# Autodesk Inventor assembly: ROBOT_FISH_2
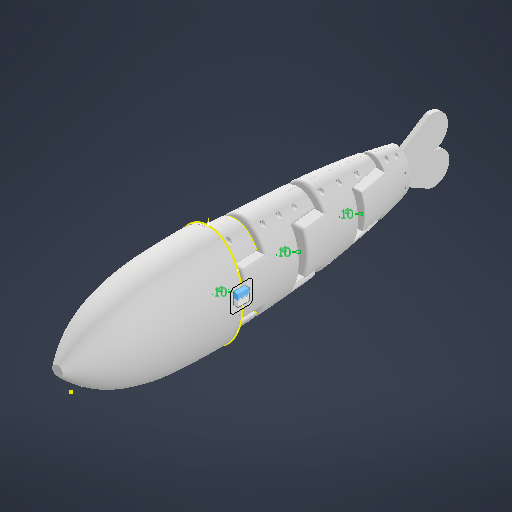
[picture p0: Inventor's stored thumbnail of the model, 512x512]
Saved by Autodesk Inventor 2026.2 (Build 302298000, 298)
## iProperties
Created: 2026-04-03
Part Number: ROBOT_FISH_2
Document SubType Name: Assembly
Designer: thita
Author: thita
## Documents named in this file (20)
- C:\Users\thita\ROBOT CÁ\ROBOT_FISH_2.iam
- C:\Users\thita\ROBOT CÁ\Solid10.ipt
- C:\Users\thita\ROBOT CÁ\Solid12.ipt
- C:\Users\thita\ROBOT CÁ\Solid14.ipt
- C:\Users\thita\ROBOT CÁ\Hop_co_servo.iam
- C:\Users\thita\ROBOT CÁ\truc_khop_1_MIR.ipt
- C:\Users\thita\ROBOT CÁ\truc_khop2_MIR.ipt
- C:\Users\thita\ROBOT CÁ\truc_khop_3_MIR.ipt
- C:\Users\thita\ROBOT CÁ\NotInProject\DAU.ipt
- C:\Users\thita\ROBOT CÁ\NotInProject\NAP.ipt
- C:\Users\thita\ROBOT CÁ\Solid14_MIR6.ipt
- C:\Users\thita\ROBOT CÁ\Solid12_MIR8.ipt
- C:\Users\thita\ROBOT CÁ\Solid10_MIR6.ipt
- C:\Users\thita\ROBOT CÁ\tail.ipt
- C:\Users\thita\ROBOT CÁ\SERVO DS35MG IP67.ipt
- C:\Users\thita\Downloads\Servo-9imod-DS35MG-180\Servo-9imod-DS35MG-180\Servo-9imod-DS35MG-180.ipt
- C:\Users\thita\ROBOT CÁ\Truc_khop_new_1.ipt
- C:\Users\thita\ROBOT CÁ\Truc_khop_new_2.ipt
- C:\Users\thita\ROBOT CÁ\Truc_khop_new_3.ipt
- C:\Users\thita\Downloads\CPB RACING BEARING (6001-2RSH) v3\CPB RACING BEARING (6001-2RSH) v3\CPB RACING BEARING (6001-2RSH) v3.ipt
## Components (26 placed, 19 different names)
1. Solid10:2 — Rigid:17, Rigid:24
2. Solid12:3 — Rigid:23, Rigid:30, Rigid:31, Rotational:9
3. Solid14:3 — Rigid:27, Rotational:7, Rigid:29, Rigid:32
4. Hop_co_servo:7 [sub-assembly] — Rigid:29
5. truc_khop_1_MIR:3
6. truc_khop2_MIR:3 — Rigid:32
7. truc_khop_3_MIR:3 — Rigid:31, Rotational:8
8. DAU:1 — Rigid:5
9. NAP:1 — Rigid:5, Rigid:20
10. Solid14_MIR6:1
11. Solid12_MIR8:1
12. Solid10_MIR6:1
13. tail:1 — Rigid:17
14. Hop_co_servo:10 [sub-assembly]
15. SERVO DS35MG IP67:1
16. Servo-9imod-DS35MG-180:1
17. Truc_khop_new_1:1 — Rigid:20
18. Truc_khop_new_2:1 — Rigid:30
19. Truc_khop_new_3:1 — Rigid:27
20. Hop_co_servo:11 [sub-assembly] — Rigid:23, Rigid:25
21. Hop_co_servo:12 [sub-assembly] — Rigid:24, Rigid:26
22. Servo-9imod-DS35MG-180:2 — Rigid:25
23. Servo-9imod-DS35MG-180:3 — Rigid:26
24. CPB RACING BEARING (6001-2RSH) v3:1 — Rotational:7
25. CPB RACING BEARING (6001-2RSH) v3:3 — Rotational:8
26. CPB RACING BEARING (6001-2RSH) v3:4 — Rotational:9
## Relationships (15: WeldJoint 12, RevoluteJoint 3)
- Rigid:5 [WeldJoint]: DAU:1 ↔ NAP:1
- Rigid:17 [WeldJoint]: Solid10:2 ↔ tail:1
- Rigid:20 [WeldJoint]: NAP:1 ↔ Truc_khop_new_1:1
- Rigid:23 [WeldJoint]: Solid12:3 ↔ Hop_co_servo:11
- Rigid:24 [WeldJoint]: Solid10:2 ↔ Hop_co_servo:12
- Rigid:25 [WeldJoint]: Hop_co_servo:11 ↔ Servo-9imod-DS35MG-180:2
- Rigid:26 [WeldJoint]: Hop_co_servo:12 ↔ Servo-9imod-DS35MG-180:3
- Rigid:27 [WeldJoint]: Solid14:3 ↔ Truc_khop_new_3:1
- Rotational:7 [RevoluteJoint]: Solid14:3 ↔ CPB RACING BEARING (6001-2RSH) v3:1
- Rigid:29 [WeldJoint]: Solid14:3 ↔ Hop_co_servo:7
- Rigid:30 [WeldJoint]: Solid12:3 ↔ Truc_khop_new_2:1
- Rigid:31 [WeldJoint]: Solid12:3 ↔ truc_khop_3_MIR:3
- Rotational:8 [RevoluteJoint]: truc_khop_3_MIR:3 ↔ CPB RACING BEARING (6001-2RSH) v3:3
- Rigid:32 [WeldJoint] (0.1 mm): Solid14:3 ↔ truc_khop2_MIR:3
- Rotational:9 [RevoluteJoint]: Solid12:3 ↔ CPB RACING BEARING (6001-2RSH) v3:4
